# Autodesk Inventor assembly: MN0542AN110_G03_PDM-0014128
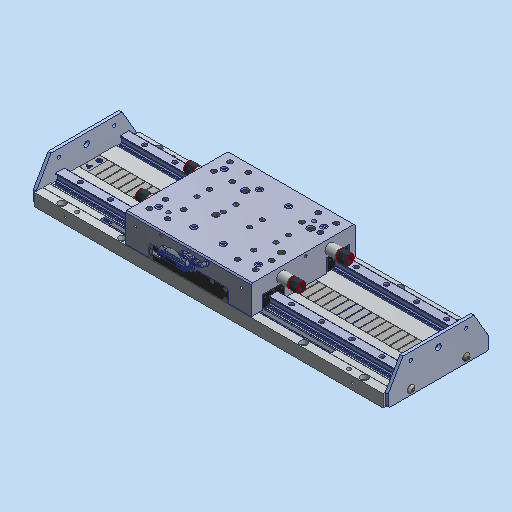
[picture p0: Inventor's stored thumbnail of the model, 512x512]
Saved by Autodesk Inventor 2023.3 (Build 273359000, 359)
## iProperties
Part Number: MN0542AN110_G03_PDM-0014128
Document SubType Name: Baugruppe
Designer: ric7an
Mass: 6294.51 g
Surface Area: 16303.1 cm^2
Volume: 6294.51 cm^3
Density: 1 g/cm^3
Author: ric7an
Revision Number: 01
## Documents named in this file (6)
- C:\Users\rea9an\Documents\Inventor\TCAI2412_te1910_EM\PT00004274.iam
- C:\Users\rea9an\Documents\Inventor\TCAI2412_te1910_EM\PT00004275.iam
- C:\Users\rea9an\Documents\Inventor\TCAI2412_te1910_EM\PT00004277.iam
- C:\Users\rea9an\Documents\Inventor\TCAI2412_te1910_EM\PT00004728.ipt
- C:\Users\rea9an\Documents\Inventor\TCAI2412_te1910_EM\PT00004383.ipt
- C:\Users\rea9an\Documents\Inventor\TCAI2412_te1910_EM\PT00004762.ipt
## Components (9 placed, 5 different names)
1. PT00004275:1 [sub-assembly] — Fluchtend:1, Fluchtend:2
2. PT00004277:1 [sub-assembly] — Fluchtend:1, Fluchtend:2, Passend:1, Passend:2, Passend:3
3. PT00004728:1 — Passend:1, Passend:2
4. PT00004383:1
5. PT00004383:2
6. PT00004728:2 — Passend:3
7. PT00004383:3
8. PT00004383:4
9. PT00004762:1
## Relationships (5: Mate 3, Flush 2)
- Fluchtend:1 [Flush] (1.3 mm): PT00004275:1 ↔ PT00004277:1
- Fluchtend:2 [Flush] (-58 mm): PT00004275:1 ↔ PT00004277:1
- Passend:1 [Mate]: PT00004277:1 ↔ PT00004728:1
- Passend:2 [Mate]: PT00004277:1 ↔ PT00004728:1
- Passend:3 [Mate]: PT00004277:1 ↔ PT00004728:2
